# Autodesk Inventor assembly: sertar_treapta_3_pat
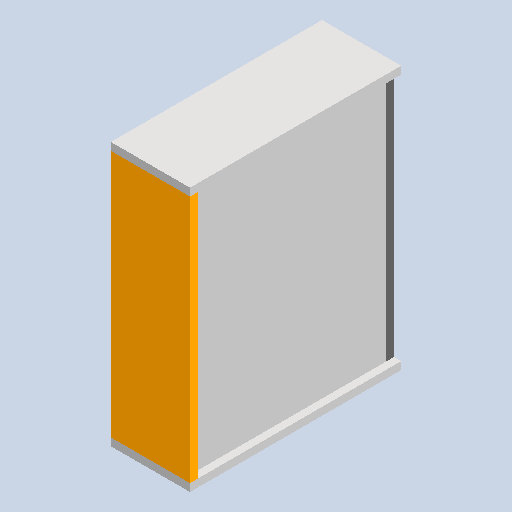
[picture p0: Inventor's stored thumbnail of the model, 512x512]
Saved by Autodesk Inventor 2022.6 (Build 266554000, 554)
## iProperties
RuleStatus: InUse
Created: 2026-11-03
Part Number: sertar_treapta_3_pat
Document SubType Name: Assembly
Designer: Dragos Macovei
Author: Dragos Macovei
## Documents named in this file (5)
- C:\Users\Dragos Macovei\Documents\3D_Parts\PAT ADI\sertar_treapta_3_pat.iam
- C:\Users\Dragos Macovei\Documents\3D_Parts\PAT ADI\perete_lateral_sertar_treapta_3_18mm.ipt
- C:\Users\Dragos Macovei\Documents\3D_Parts\PAT ADI\fund_sertar_treapta_3.ipt
- C:\Users\Dragos Macovei\Documents\3D_Parts\PAT ADI\spatele_sertar_inferior_trepte.ipt
- C:\Users\Dragos Macovei\Documents\3D_Parts\PAT ADI\fata_sertar_inferior_trepte.ipt
## Components (5 placed, 4 different names)
1. perete_lateral_sertar_treapta_3_18mm:1 — Mate:5, Flush:1, Mate:7, Flush:2, Flush:3
2. perete_lateral_sertar_treapta_3_18mm:2 — Mate:8, Flush:4, Flush:5, Mate:9
3. fund_sertar_treapta_3:1 — Mate:5, Mate:6, Mate:10, Flush:6
4. spatele_sertar_inferior_trepte:1 — Mate:6, Flush:1, Mate:9, Flush:6
5. fata_sertar_inferior_trepte:1 — Mate:7, Flush:2, Flush:3, Mate:8, Flush:4, Flush:5, Mate:10
## Relationships (12: Mate 6, Flush 6)
- Mate:5: perete_lateral_sertar_treapta_3_18mm:1 ↔ fund_sertar_treapta_3:1
- Mate:6: fund_sertar_treapta_3:1 ↔ spatele_sertar_inferior_trepte:1
- Flush:1: perete_lateral_sertar_treapta_3_18mm:1 ↔ spatele_sertar_inferior_trepte:1
- Mate:7: perete_lateral_sertar_treapta_3_18mm:1 ↔ fata_sertar_inferior_trepte:1
- Flush:2: perete_lateral_sertar_treapta_3_18mm:1 ↔ fata_sertar_inferior_trepte:1
- Flush:3: perete_lateral_sertar_treapta_3_18mm:1 ↔ fata_sertar_inferior_trepte:1
- Mate:8: perete_lateral_sertar_treapta_3_18mm:2 ↔ fata_sertar_inferior_trepte:1
- Flush:4: perete_lateral_sertar_treapta_3_18mm:2 ↔ fata_sertar_inferior_trepte:1
- Flush:5: perete_lateral_sertar_treapta_3_18mm:2 ↔ fata_sertar_inferior_trepte:1
- Mate:9: perete_lateral_sertar_treapta_3_18mm:2 ↔ spatele_sertar_inferior_trepte:1
- Mate:10: fund_sertar_treapta_3:1 ↔ fata_sertar_inferior_trepte:1
- Flush:6: fund_sertar_treapta_3:1 ↔ spatele_sertar_inferior_trepte:1
